# Autodesk Inventor assembly: RDS-2100 Panel Rack
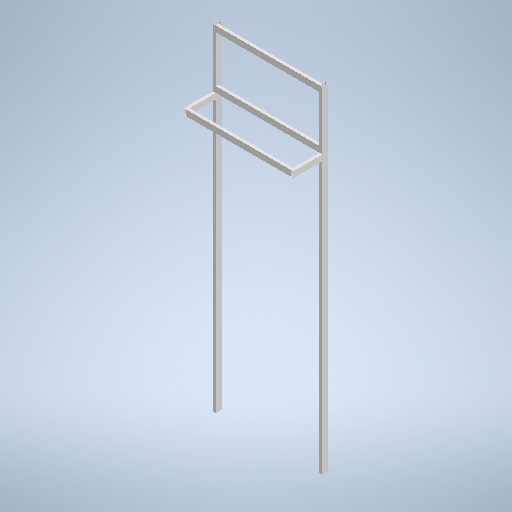
[picture p0: Inventor's stored thumbnail of the model, 512x512]
Saved by Autodesk Inventor 2026 (Build 300175000, 175)
## iProperties
Created: 2026-10-12
Part Number: RDS-2100 Panel Rack
Description: Dosing panel rack
Document SubType Name: Assembly
Designer: admin
Stock Number: Стойка панели дозаторов 750х2300, труба 40х20х2
Author: admin
## Documents named in this file (6)
- C:\Users\user\Documents\Inventor\RDS-Reagent-Dosing-Station\Frame\RDS-2100 Panel Rack.iam
- C:\Users\user\Documents\Inventor\RDS-Reagent-Dosing-Station\Frame\RDS-2004 Tube 40x20 L2300.ipt
- C:\Users\user\Documents\Inventor\RDS-Reagent-Dosing-Station\Frame\RDS-2003 Tube 40x20 L710.ipt
- C:\Users\user\Documents\Inventor\RDS-Reagent-Dosing-Station\Frame\RDS-2005 Tube 40x20 L200.ipt
- C:\Users\user\Documents\Inventor\RDS-Reagent-Dosing-Station\Frame\RDS-2003 Tube 40x20 L7102.ipt
- C:\Users\user\Documents\Inventor\RDS-Reagent-Dosing-Station\Frame\RDS-2005 Tube 40x20 L2001.ipt
## Components (7 placed, 5 different names)
1. RDS-2004 Tube 40x20 L2300:1 — Заподлицо:1, Заподлицо:2
2. RDS-2004 Tube 40x20 L2300:2 — Совмещение:1, Заподлицо:3
3. RDS-2003 Tube 40x20 L710:1 — Совмещение:2
4. RDS-2003 Tube 40x20 L710:2
5. RDS-2005 Tube 40x20 L200:1 — Заподлицо:1, Заподлицо:2, Жесткий:1
6. RDS-2003 Tube 40x20 L710:2:1 — Жесткий:1
7. RDS-2005 Tube 40x20 L200_2:1 — Совмещение:1, Заподлицо:3, Совмещение:2
## Relationships (6: Flush 3, Mate 2, WeldJoint 1)
- Заподлицо:1 [Flush]: RDS-2004 Tube 40x20 L2300:1 ↔ RDS-2005 Tube 40x20 L200:1
- Заподлицо:2 [Flush]: RDS-2004 Tube 40x20 L2300:1 ↔ RDS-2005 Tube 40x20 L200:1
- Совмещение:1 [Mate]: RDS-2004 Tube 40x20 L2300:2 ↔ RDS-2005 Tube 40x20 L200_2:1
- Заподлицо:3 [Flush]: RDS-2004 Tube 40x20 L2300:2 ↔ RDS-2005 Tube 40x20 L200_2:1
- Совмещение:2 [Mate]: RDS-2003 Tube 40x20 L710:1 ↔ RDS-2005 Tube 40x20 L200_2:1
- Жесткий:1 [WeldJoint]: RDS-2005 Tube 40x20 L200:1 ↔ RDS-2003 Tube 40x20 L710:2:1
